# Autodesk Inventor assembly: pattern-circ-z6
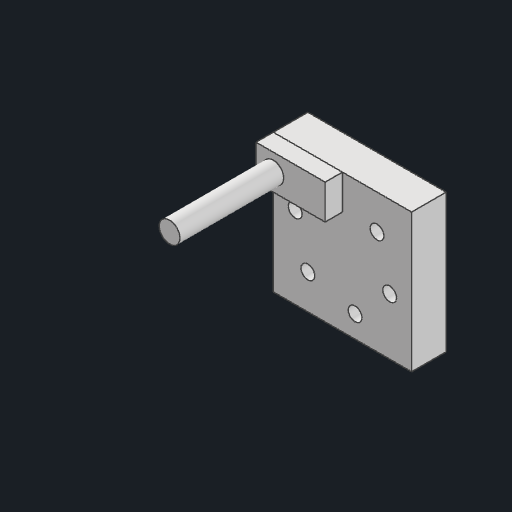
[picture p0: Inventor's stored thumbnail of the model, 512x512]
Saved by Autodesk Inventor 2026.1 (Build 301233000, 233)
## iProperties
Created: 2026-10-30
Part Number: pattern-circ-z6
Document SubType Name: Assembly
Designer: anony
Author: anony
## Documents named in this file (4)
- C:\Users\anony\OneDrive\Desktop\AI Projects\CAD Convert\corpus\generated\asmgrip\pattern-circ-z6.iam
- C:\Users\anony\OneDrive\Desktop\AI Projects\CAD Convert\corpus\generated\asmparts\box.ipt
- C:\Users\anony\OneDrive\Desktop\AI Projects\CAD Convert\corpus\generated\asmparts\pin.ipt
- C:\Users\anony\OneDrive\Desktop\AI Projects\CAD Convert\corpus\generated\pattern-circ\z6.ipt
## Components (3 placed, 3 different names)
1. box:1 — Mate:2, Mate:3, Mate:4, Mate:5, Mate:6, Mate:7, Mate:13, Mate:14, Mate:15, Mate:16, Mate:17, Mate:18, Mate:19, Mate:20, Mate:21, Mate:22
2. pin:1 — Mate:1, Mate:8, Mate:9, Mate:10, Mate:11, Mate:12, Insert:1, Insert:2, Insert:3, Insert:4, Insert:5, Insert:6, Insert:7, Insert:8, Insert:9, Insert:10, Insert:11, Insert:12
3. z6:1 — Mate:1, Mate:2, Mate:3, Mate:4, Mate:5, Mate:6, Mate:7, Mate:8, Mate:9, Mate:10, Mate:11, Mate:12, Insert:1, Insert:2, Insert:3, Insert:4, Insert:5, Insert:6, Insert:7, Insert:8, Insert:9, Insert:10, Insert:11, Insert:12, Mate:13, Mate:14, Mate:15, Mate:16, Mate:17, Mate:18, Mate:19, Mate:20, Mate:21, Mate:22
## Relationships (34: Mate 22, Insert 12)
- Mate:1: pin:1 ↔ z6:1
- Mate:2: box:1 ↔ z6:1
- Mate:3: box:1 ↔ z6:1
- Mate:4: box:1 ↔ z6:1
- Mate:5: box:1 ↔ z6:1
- Mate:6: box:1 ↔ z6:1
- Mate:7: box:1 ↔ z6:1
- Mate:8: pin:1 ↔ z6:1
- Mate:9: pin:1 ↔ z6:1
- Mate:10: pin:1 ↔ z6:1
- Mate:11: pin:1 ↔ z6:1
- Mate:12: pin:1 ↔ z6:1
- Insert:1: pin:1 ↔ z6:1
- Insert:2: pin:1 ↔ z6:1
- Insert:3: pin:1 ↔ z6:1
- Insert:4: pin:1 ↔ z6:1
- Insert:5: pin:1 ↔ z6:1
- Insert:6: pin:1 ↔ z6:1
- Insert:7: pin:1 ↔ z6:1
- Insert:8: pin:1 ↔ z6:1
- Insert:9: pin:1 ↔ z6:1
- Insert:10: pin:1 ↔ z6:1
- Insert:11: pin:1 ↔ z6:1
- Insert:12: pin:1 ↔ z6:1
- Mate:13: box:1 ↔ z6:1
- Mate:14: box:1 ↔ z6:1
- Mate:15: box:1 ↔ z6:1
- Mate:16: box:1 ↔ z6:1
- Mate:17: box:1 ↔ z6:1
- Mate:18: box:1 ↔ z6:1
- Mate:19: box:1 ↔ z6:1
- Mate:20: box:1 ↔ z6:1
- Mate:21: box:1 ↔ z6:1
- Mate:22: box:1 ↔ z6:1
